# Autodesk Inventor assembly: MM0948AN170_G00_809
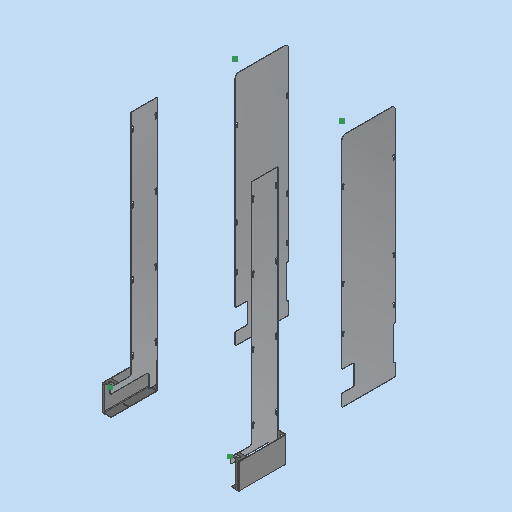
[picture p0: Inventor's stored thumbnail of the model, 512x512]
Saved by Autodesk Inventor 2023.3 (Build 273359000, 359)
## iProperties
Created: 2023-03-23
Part Number: MM0948AN170_G00_809
Description: =<RBPARTNOTITLE2>
Document SubType Name: Assembly
Designer: FH/Wi
Mass: 8135.05 g
Surface Area: 23555.4 cm^2
Volume: 2419.31 cm^3
Density: 3.36256 g/cm^3
AnP_Kategorie: 98
AnP_Material: =<Material>
AnP_TemplVers: 20200821
RBDOCUMENTTYPE: DRF
RBDOCUMENTVERSION: 00
RBDRAWINGMAINSCALE: 1:1
RBDRAWINGMISSINGSPEC: --
RBDRAWINGVOLUME: --
RBDSV1: 0850
RBGBEDGESIN1: +0,5
RBGBEDGESIN2: +0,2
RBGBEDGESOUT1: -0,3
RBGBEDGESOUT2: -0,1
RBMATERIAL: =<Material>
RBMATMEETS: --
RBMATNO: =<Part Number>
RBPARTMADEOF: --
RBPARTNO: SIEHE MNR
RBPARTNOTITLE1: enter description here
RBPARTNOTITLE2: hier Bezeichnung eintragen
RBPARTSAFETYINDICATOR: --
RBSURFACE: --
RBSURFACE2: --
RBZEDGESNORM: ISO13715:2002-06
RBZGENDIMCLASS: m
RBZGENDIMNORM: ISO 2768-1:1989-11
RBZGENGEOCLASS: H
RBZGENGEONORM: ISO 2768-2:1989-11
RBZSURFACENORM: ISO13D2:2002-02
RBZTOLERANCENORM: ISO 14405-1:2010-12
Author: FH/Wi
Keywords: =<RBPARTMADEOF>
Comments: =<RBSURFACE2>
Revision Number: 01
## Documents named in this file (5)
- C:\Users\rea9an\Documents\Inventor\TCAI2412_te1910_EM\AS00000963.iam
- C:\Users\rea9an\Documents\Inventor\TCAI2412_te1910_EM\PT00004701.ipt
- C:\Users\rea9an\Documents\Inventor\TCAI2412_te1910_EM\PT00004703.ipt
- C:\Users\rea9an\Documents\Inventor\TCAI2412_te1910_EM\PT00004459.ipt
- C:\Users\rea9an\Documents\Inventor\TCAI2412_te1910_EM\PT00004460.ipt
## Components (6 placed, 4 different names)
1. PT00004701:1
2. PT00004701:2
3. PT00004460:1
4. PT00004459:1
5. PT00004703:1 — Fluchtend:3, Passend:1, Fluchtend:4
6. PT00004703:2 — Passend:2
## Relationships (6: Flush 4, Mate 2)
- [Flush]: PT00004703:1 ↔ PT00004703:2
- [Flush]: PT00004703:1 ↔ PT00004703:2
- Fluchtend:3 [Flush] (285 mm): PT00004703:1
- Passend:1 [Mate] (1284 mm): PT00004703:1
- Fluchtend:4 [Flush] (-45 mm): PT00004703:1
- Passend:2 [Mate] (-285 mm): PT00004703:2
